# Autodesk Inventor assembly: assembly
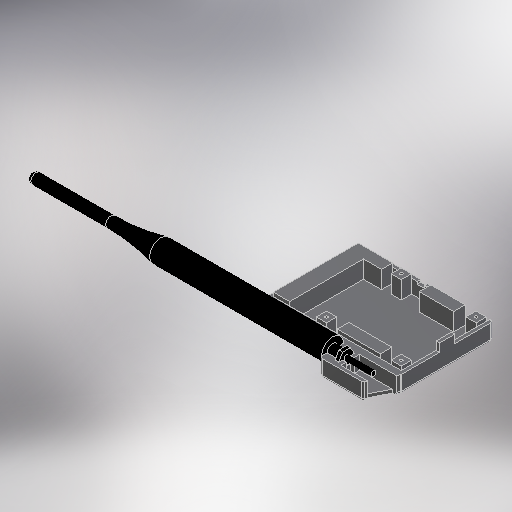
[picture p0: Inventor's stored thumbnail of the model, 512x512]
Saved by Autodesk Inventor 2027 (Build 310192060, 192F)
## iProperties
Created: 2026-09-11
Part Number: assembly
Document SubType Name: Assembly
Designer: Aiden
Author: Aiden
## Documents named in this file (3)
- C:\Users\Aiden\Desktop\Aiden's Inventor\meshnode\assembly.iam
- C:\Users\Aiden\Desktop\Aiden's Inventor\meshnode\back_casing.ipt
- C:\Users\Aiden\Desktop\Aiden's Inventor\meshnode\antenna.ipt
## Components (2 placed, 2 different names)
1. back_casing:1 — Mate:1, Mate:2, Mate:3
2. antenna:1 — Mate:1, Mate:2, Mate:3
## Relationships (3: Mate 3)
- Mate:1: back_casing:1 ↔ antenna:1
- Mate:2: back_casing:1 ↔ antenna:1
- Mate:3: back_casing:1 ↔ antenna:1
